# Autodesk Inventor assembly: Elec_enclosure_ASM
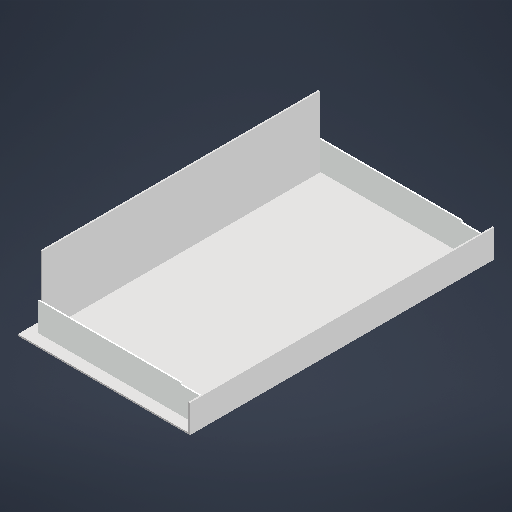
[picture p0: Inventor's stored thumbnail of the model, 512x512]
Saved by Autodesk Inventor 2026.2 (Build 302298010, 298A)
## iProperties
Created: 2026-10-11
Part Number: Elec_enclosure_ASM
Document SubType Name: Assembly
Designer: User
Author: User
## Documents named in this file (5)
- D:\Autodesk Invento Pro Work\Honours Project\Parts\Elec_enclosure_ASM.iam
- D:\Autodesk Invento Pro Work\Honours Project\Parts\Elec_enclosure_top.ipt
- D:\Autodesk Invento Pro Work\Honours Project\Parts\Elec_enclosure_back.ipt
- D:\Autodesk Invento Pro Work\Honours Project\Parts\Elec_enclosure_front.ipt
- D:\Autodesk Invento Pro Work\Honours Project\Parts\enclosure_side.ipt
## Components (5 placed, 4 different names)
1. Elec_enclosure_top:1 — Rigid:1, Slider:1
2. Elec_enclosure_back:1 — Rigid:1, Slider:2, Slider:3
3. Elec_enclosure_front:1 — Slider:1
4. enclosure_side:2 — Slider:2
5. enclosure_side:3 — Slider:3
## Relationships (4: TranslationJoint 3, WeldJoint 1)
- Rigid:1 [WeldJoint] (-2.5 mm): Elec_enclosure_top:1 ↔ Elec_enclosure_back:1
- Slider:1 [TranslationJoint] (-2.5 mm): Elec_enclosure_top:1 ↔ Elec_enclosure_front:1
- Slider:2 [TranslationJoint]: Elec_enclosure_back:1 ↔ enclosure_side:2
- Slider:3 [TranslationJoint]: Elec_enclosure_back:1 ↔ enclosure_side:3
